# Autodesk Inventor assembly: FinalAssembly
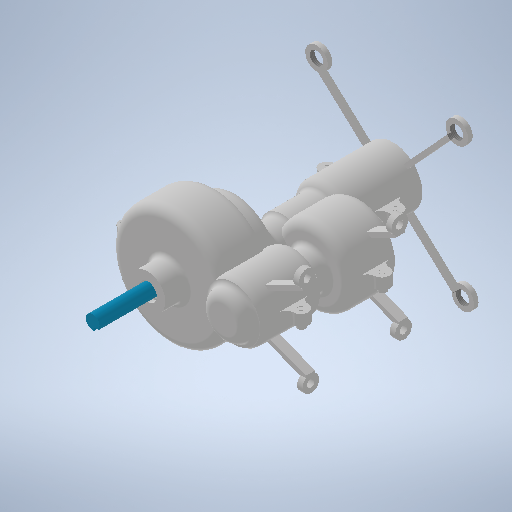
[picture p0: Inventor's stored thumbnail of the model, 512x512]
Saved by Autodesk Inventor 2025 (Build 290162000, 162)
## iProperties
Created: 2024-05-30
Part Number: FinalAssembly
Document SubType Name: Assembly
Designer: BenFr
Author: BenFr
## Documents named in this file (6)
- C:\Users\BenFr\OneDrive\Documents\GearReducer\FinalAssembly.iam
- C:\Users\BenFr\OneDrive\Documents\GearReducer\Shelled2.ipt
- C:\Users\BenFr\OneDrive\Documents\GearReducer\AssemblyPart.ipt
- C:\Users\BenFr\OneDrive\Documents\GearReducer\OutputSeal.ipt
- C:\Users\BenFr\OneDrive\Documents\GearReducer\InputSeal1.ipt
- C:\Users\BenFr\OneDrive\Documents\GearReducer\Bolt.ipt
## Components (9 placed, 5 different names)
1. Shelled2:1 — Rotational:1, Rotational:2, Rotational:3, Rotational:4, Rigid:3
2. AssemblyPart:1 — Rigid:1, Rigid:2
3. OutputSeal:1 — Rigid:2
4. InputSeal1:1 — Rigid:1
5. Bolt:1 — Rotational:1
6. Bolt:2 — Rotational:2
7. Bolt:3 — Rotational:3
8. Bolt:4 — Rotational:4
9. Bolt:5 — Rigid:3
## Relationships (7: RevoluteJoint 4, WeldJoint 3)
- Rigid:1 [WeldJoint] (7.5 mm): AssemblyPart:1 ↔ InputSeal1:1
- Rigid:2 [WeldJoint] (67.5 mm): AssemblyPart:1 ↔ OutputSeal:1
- Rotational:1 [RevoluteJoint]: Shelled2:1 ↔ Bolt:1
- Rotational:2 [RevoluteJoint]: Shelled2:1 ↔ Bolt:2
- Rotational:3 [RevoluteJoint]: Shelled2:1 ↔ Bolt:3
- Rotational:4 [RevoluteJoint]: Shelled2:1 ↔ Bolt:4
- Rigid:3 [WeldJoint]: Shelled2:1 ↔ Bolt:5
